# Autodesk Inventor assembly: MM0937AN100_G15_005
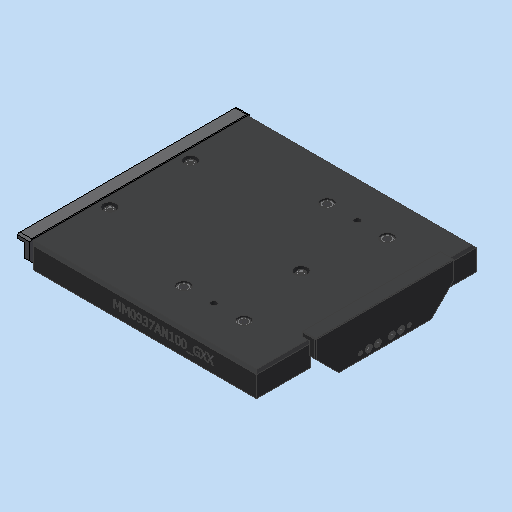
[picture p0: Inventor's stored thumbnail of the model, 512x512]
Saved by Autodesk Inventor 2023.3 (Build 273359000, 359)
## iProperties
Created: 2018-10-19
Part Number: MM0937AN100_G15_005
Document SubType Name: Assembly
Designer: Rose
Mass: 5272.97 g
Surface Area: 1633.83 cm^2
Volume: 672.008 cm^3
Density: 7.84659 g/cm^3
AnP_Kommentar_aktuell: =<Comments>
AnP_Material_aktuell: =<Material>
Author: Rose
Revision Number: 01
## Documents named in this file (13)
- C:\Users\rea9an\Documents\Inventor\TCAI2412_te1910_EM\AS00000911.iam
- C:\Users\rea9an\Documents\Inventor\TCAI2412_te1910_EM\PT00004864.ipt
- C:\Users\rea9an\Documents\Inventor\TCAI2412_te1910_EM\PT00004912.ipt
- C:\Users\rea9an\Documents\Inventor\TCAI2412_te1910_EM\PT00004872.ipt
- C:\Users\rea9an\Documents\Inventor\TCAI2412_te1910_EM\PT00004414.ipt
- C:\Users\rea9an\Documents\Inventor\TCAI2412_te1910_EM\PT00004415.ipt
- C:\Users\rea9an\Documents\Inventor\TCAI2412_te1910_EM\PT00004416.ipt
- C:\Users\rea9an\Documents\Inventor\TCAI2412_te1910_EM\PT00004417.ipt
- C:\Users\rea9an\Documents\Inventor\TCAI2412_te1910_EM\PT00004418.ipt
- C:\Users\rea9an\Documents\Inventor\TCAI2412_te1910_EM\PT00004419.ipt
- C:\Users\rea9an\Documents\Inventor\TCAI2412_te1910_EM\PT00004923.ipt
- C:\Users\rea9an\Documents\Inventor\TCAI2412_te1910_EM\PT00004889.ipt
- C:\Users\rea9an\Documents\Inventor\TCAI2412_te1910_EM\PT00004550.ipt
## Components (37 placed, 12 different names)
1. PT00004550:1 — Einfügen:3, Einfügen:4, Einfügen:5, Passend:4, Passend:5, Passend:6, Passend:7, Passend:8, Passend:9, Einfügen:21, Einfügen:22, Einfügen:23, Einfügen:34, Einfügen:35
2. PT00004414:1 — Einfügen:10, Einfügen:11, Einfügen:12, Einfügen:13, Einfügen:14, Einfügen:15, Einfügen:16, Einfügen:17, Einfügen:18, Einfügen:19, Einfügen:20
3. PT00004415:1 — Passend:1, Passend:2, Passend:3, Einfügen:10, Einfügen:11, Einfügen:1, Einfügen:2
4. PT00004416:1 — Einfügen:1, Einfügen:2, Einfügen:28, Einfügen:29, Einfügen:30, Einfügen:31, Einfügen:32, Einfügen:33
5. PT00004417:1 — Einfügen:3, Passend:3
6. PT00004417:2 — Einfügen:4
7. PT00004417:3 — Einfügen:5, Passend:1, Passend:2
8. PT00004418:1 — Passend:5, Passend:6
9. PT00004418:2 — Passend:4, Passend:7
10. PT00004418:3 — Passend:8, Passend:9
11. PT00004419:1 — Einfügen:21
12. PT00004419:2 — Einfügen:22
13. PT00004419:3 — Einfügen:23
14. PT00004864:1 — Einfügen:12
15. PT00004864:2 — Einfügen:13
16. PT00004864:3 — Einfügen:14
17. PT00004864:4 — Einfügen:15
18. PT00004864:5 — Einfügen:16
19. PT00004864:6 — Einfügen:17
20. PT00004864:7 — Einfügen:18
21. PT00004864:8 — Einfügen:30
22. PT00004864:9 — Einfügen:31
23. PT00004864:10 — Einfügen:32
24. PT00004864:11 — Einfügen:33
25. PT00004872:1
26. PT00004872:2
27. PT00004872:3
28. PT00004889:1
29. PT00004889:2
30. PT00004912:1 — Einfügen:20
31. PT00004912:2 — Einfügen:19
32. PT00004923:2
33. PT00004923:1
34. PT00004912:3 — Einfügen:28
35. PT00004912:4 — Einfügen:29
36. PT00004889:3 — Einfügen:34
37. PT00004889:4 — Einfügen:35
## Relationships (43: Insert 34, Mate 9)
- Einfügen:1 [Insert]: PT00004415:1 ↔ PT00004416:1
- Einfügen:2 [Insert]: PT00004415:1 ↔ PT00004416:1
- Einfügen:3 [Insert]: PT00004550:1 ↔ PT00004417:1
- Einfügen:4 [Insert]: PT00004550:1 ↔ PT00004417:2
- Einfügen:5 [Insert]: PT00004550:1 ↔ PT00004417:3
- [Insert]: PT00004417:1 ↔ PT00004872:1
- [Insert]: PT00004417:2 ↔ PT00004872:3
- [Insert]: PT00004417:3 ↔ PT00004872:2
- Passend:1 [Mate] (1.8 mm): PT00004415:1 ↔ PT00004417:3
- Passend:2 [Mate]: PT00004415:1 ↔ PT00004417:3
- Passend:3 [Mate]: PT00004415:1 ↔ PT00004417:1
- Passend:4 [Mate]: PT00004550:1 ↔ PT00004418:2
- Passend:5 [Mate]: PT00004550:1 ↔ PT00004418:1
- Passend:6 [Mate]: PT00004550:1 ↔ PT00004418:1
- Passend:7 [Mate]: PT00004550:1 ↔ PT00004418:2
- Einfügen:10 [Insert]: PT00004414:1 ↔ PT00004415:1
- Einfügen:11 [Insert]: PT00004414:1 ↔ PT00004415:1
- Passend:8 [Mate]: PT00004550:1 ↔ PT00004418:3
- Passend:9 [Mate]: PT00004550:1 ↔ PT00004418:3
- Einfügen:12 [Insert]: PT00004414:1 ↔ PT00004864:1
- Einfügen:13 [Insert]: PT00004414:1 ↔ PT00004864:2
- Einfügen:14 [Insert]: PT00004414:1 ↔ PT00004864:3
- Einfügen:15 [Insert]: PT00004414:1 ↔ PT00004864:4
- Einfügen:16 [Insert]: PT00004414:1 ↔ PT00004864:5
- Einfügen:17 [Insert]: PT00004414:1 ↔ PT00004864:6
- Einfügen:18 [Insert]: PT00004414:1 ↔ PT00004864:7
- Einfügen:19 [Insert]: PT00004414:1 ↔ PT00004912:2
- Einfügen:20 [Insert]: PT00004414:1 ↔ PT00004912:1
- Einfügen:21 [Insert]: PT00004550:1 ↔ PT00004419:1
- Einfügen:22 [Insert]: PT00004550:1 ↔ PT00004419:2
- Einfügen:23 [Insert]: PT00004550:1 ↔ PT00004419:3
- [Insert]: PT00004550:1 ↔ PT00004889:2
- [Insert]: PT00004550:1 ↔ PT00004889:1
- [Insert] (1 mm): PT00004550:1 ↔ PT00004923:2
- [Insert] (1 mm): PT00004550:1 ↔ PT00004923:1
- Einfügen:28 [Insert]: PT00004416:1 ↔ PT00004912:3
- Einfügen:29 [Insert]: PT00004416:1 ↔ PT00004912:4
- Einfügen:30 [Insert]: PT00004416:1 ↔ PT00004864:8
- Einfügen:31 [Insert]: PT00004416:1 ↔ PT00004864:9
- Einfügen:32 [Insert]: PT00004416:1 ↔ PT00004864:10
- Einfügen:33 [Insert]: PT00004416:1 ↔ PT00004864:11
- Einfügen:34 [Insert]: PT00004550:1 ↔ PT00004889:3
- Einfügen:35 [Insert]: PT00004550:1 ↔ PT00004889:4
